# Autodesk Inventor assembly: Profile Skeleton
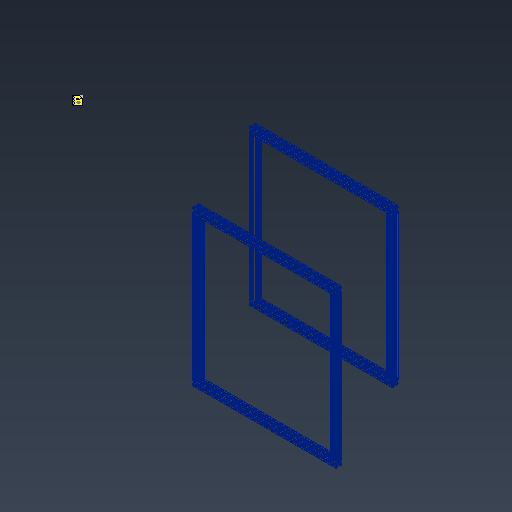
[picture p0: Inventor's stored thumbnail of the model, 512x512]
Saved by Autodesk Inventor 2026.2 (Build 302298010, 298A)
## iProperties
Created: 2026-05-13
Part Number: Profile Skeleton
Document SubType Name: Assembly
Designer: khw
Mass: 2480.34 g
Surface Area: 8755.86 cm^2
Volume: 918.645 cm^3
Density: 2.7 g/cm^3
Author: khw
## iProperties of the stored document _VirtualPart0
Part Number: 구성요소1
Material: 일반
## iProperties of the stored document MemberDocs/x1qkhal55Okb3g1scFdafxuwl4e
Created: 2026-05-13
Part Number: Profile Skeleton
Document SubType Name: Assembly
Designer: khw
Mass: 2480.34 g
Surface Area: 8755.86 cm^2
Volume: 918.645 cm^3
Density: 2.7 g/cm^3
Author: khw
## Documents named in this file (4)
- C:\Users\khw\Desktop\ARD_v1\ARD_hardware\Profile Skeleton.iam
- C:\Users\khw\Desktop\ARD_v1\ARD_hardware\Common Objects\Profile\2020 Profile Series\2020Profile-500mm.ipt
- C:\Users\khw\Desktop\ARD_v1\ARD_hardware\Common Objects\Profile\2020 Angle Corner Brecket.ipt
- C:\Users\khw\Desktop\ARD_v1\ARD_hardware\Common Objects\Bolt Nut\JIS B 1176 - M4 x 12 - 0.7.ipt
## Components (9 placed, 2 different names)
1. 2020Profile-500mm:1 — 메이트:1, 플러쉬:3, 플러쉬:4
2. 2020Profile-500mm:2 — 메이트:2, 플러쉬:1, 플러쉬:2, 메이트:3, 플러쉬:5, 플러쉬:6
3. 2020Profile-500mm:3 — 메이트:1, 메이트:2, 플러쉬:1, 플러쉬:2, 플러쉬:3, 플러쉬:4
4. 2020Profile-500mm:5 — 메이트:3, 플러쉬:5, 플러쉬:6
5. 2020Profile-500mm:6
6. 2020Profile-500mm:7
7. 2020Profile-500mm:8
8. 2020Profile-500mm:9
9. 구성요소1:1
## Relationships (18: Flush 12, Mate 6)
- 메이트:1 [Mate]: 2020Profile-500mm:1 ↔ 2020Profile-500mm:3
- 메이트:2 [Mate]: 2020Profile-500mm:2 ↔ 2020Profile-500mm:3
- 플러쉬:1 [Flush]: 2020Profile-500mm:2 ↔ 2020Profile-500mm:3
- 플러쉬:2 [Flush]: 2020Profile-500mm:2 ↔ 2020Profile-500mm:3
- 플러쉬:3 [Flush]: 2020Profile-500mm:1 ↔ 2020Profile-500mm:3
- 플러쉬:4 [Flush]: 2020Profile-500mm:1 ↔ 2020Profile-500mm:3
- 메이트:3 [Mate]: 2020Profile-500mm:2 ↔ 2020Profile-500mm:5
- 플러쉬:5 [Flush]: 2020Profile-500mm:2 ↔ 2020Profile-500mm:5
- 플러쉬:6 [Flush]: 2020Profile-500mm:2 ↔ 2020Profile-500mm:5
- [Mate]: 2020Profile-500mm:6 ↔ 2020Profile-500mm:8
- [Mate]: 2020Profile-500mm:7 ↔ 2020Profile-500mm:8
- [Flush]: 2020Profile-500mm:7 ↔ 2020Profile-500mm:8
- [Flush]: 2020Profile-500mm:7 ↔ 2020Profile-500mm:8
- [Flush]: 2020Profile-500mm:6 ↔ 2020Profile-500mm:8
- [Flush]: 2020Profile-500mm:6 ↔ 2020Profile-500mm:8
- [Mate]: 2020Profile-500mm:7 ↔ 2020Profile-500mm:9
- [Flush]: 2020Profile-500mm:7 ↔ 2020Profile-500mm:9
- [Flush]: 2020Profile-500mm:7 ↔ 2020Profile-500mm:9
## Named parameters: d9_d0 = 0 mm, d10_d1 = 0 mm, d11_d2 = 0 mm, d12_d3 = 0 mm, d13_d4 = 0 mm, d14_d5 = 0 mm, d15_d6 = 0 mm, d16_d7 = 0 mm, d17_d8 = 0 mm
